# Autodesk Inventor assembly: pat de mijloc 125x190
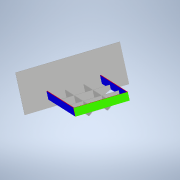
[picture p0: Inventor's stored thumbnail of the model, 180x180]
Saved by Autodesk Inventor 2022.6 (Build 266554000, 554)
## iProperties
Created: 2025-04-03
Part Number: pat de mijloc 125x190
Document SubType Name: Assembly
Designer: Dragos Macovei
Author: Dragos Macovei
## Documents named in this file (9)
- C:\Users\Dragos Macovei\Documents\Inventor_3d_parts\PAT\pat de mijloc 125x190.iam
- C:\Users\Dragos Macovei\Documents\Inventor_3d_parts\PAT\frontar.ipt
- C:\Users\Dragos Macovei\Documents\Inventor_3d_parts\PAT\laterala_dreapta.ipt
- C:\Users\Dragos Macovei\Documents\Inventor_3d_parts\PAT\laterala_stanga.ipt
- C:\Users\Dragos Macovei\Documents\Inventor_3d_parts\PAT\INTARITURA_STG_DR_MID.ipt
- C:\Users\Dragos Macovei\Documents\Inventor_3d_parts\PAT\INTARITURA_FRONTAR.ipt
- C:\Users\Dragos Macovei\Documents\Inventor_3d_parts\PAT\intaritura_centru.ipt
- C:\Users\Dragos Macovei\Documents\Inventor_3d_parts\PAT\intaritura_spatare.ipt
- C:\Users\Dragos Macovei\Documents\Inventor_3d_parts\PAT\spatar.ipt
## Components (12 placed, 8 different names)
1. frontar:1 — Mate:1, Flush:1, Flush:2, Flush:3, Flush:4, Mate:2, Mate:5, Mate:6
2. laterala_dreapta:1 — Mate:1, Flush:1, Flush:2, Mate:20
3. laterala_stanga:1 — Flush:3, Flush:4, Mate:2, Mate:3, Flush:5, Flush:6, Mate:4, Mate:19, Flush:14
4. INTARITURA_STG_DR_MID:1 — Mate:3, Flush:5, Mate:5, Mate:7, Mate:8, Flush:7, Flush:8, Mate:9, Mate:10
5. INTARITURA_STG_DR_MID:2 — Flush:6, Mate:4, Mate:6, Mate:11, Mate:12, Flush:9, Flush:10, Mate:13, Mate:14, Mate:15, Mate:16, Flush:11, Flush:12, Mate:17, Mate:18
6. INTARITURA_FRONTAR:1 — Mate:8, Flush:7, Mate:9
7. INTARITURA_FRONTAR:2 — Mate:7, Flush:8, Mate:10
8. intaritura_centru:1 — Mate:11, Flush:9, Mate:14
9. intaritura_centru:2 — Mate:12, Flush:10, Mate:13
10. intaritura_spatare:1 — Mate:16, Flush:11, Mate:17, Flush:13
11. intaritura_spatare:2 — Mate:15, Flush:12, Mate:18
12. spatar:1 — Mate:19, Mate:20, Flush:13, Flush:14
## Relationships (34: Mate 20, Flush 14)
- Mate:1: frontar:1 ↔ laterala_dreapta:1
- Flush:1: frontar:1 ↔ laterala_dreapta:1
- Flush:2: frontar:1 ↔ laterala_dreapta:1
- Flush:3: frontar:1 ↔ laterala_stanga:1
- Flush:4: frontar:1 ↔ laterala_stanga:1
- Mate:2: frontar:1 ↔ laterala_stanga:1
- Mate:3: laterala_stanga:1 ↔ INTARITURA_STG_DR_MID:1
- Flush:5 (-100 mm): laterala_stanga:1 ↔ INTARITURA_STG_DR_MID:1
- Flush:6 (100 mm): laterala_stanga:1 ↔ INTARITURA_STG_DR_MID:2
- Mate:4: laterala_stanga:1 ↔ INTARITURA_STG_DR_MID:2
- Mate:5 (630 mm): frontar:1 ↔ INTARITURA_STG_DR_MID:1
- Mate:6 (1260 mm): frontar:1 ↔ INTARITURA_STG_DR_MID:2
- Mate:7: INTARITURA_STG_DR_MID:1 ↔ INTARITURA_FRONTAR:2
- Mate:8: INTARITURA_STG_DR_MID:1 ↔ INTARITURA_FRONTAR:1
- Flush:7: INTARITURA_STG_DR_MID:1 ↔ INTARITURA_FRONTAR:1
- Flush:8: INTARITURA_STG_DR_MID:1 ↔ INTARITURA_FRONTAR:2
- Mate:9: INTARITURA_STG_DR_MID:1 ↔ INTARITURA_FRONTAR:1
- Mate:10: INTARITURA_STG_DR_MID:1 ↔ INTARITURA_FRONTAR:2
- Mate:11: INTARITURA_STG_DR_MID:2 ↔ intaritura_centru:1
- Mate:12: INTARITURA_STG_DR_MID:2 ↔ intaritura_centru:2
- Flush:9: INTARITURA_STG_DR_MID:2 ↔ intaritura_centru:1
- Flush:10: INTARITURA_STG_DR_MID:2 ↔ intaritura_centru:2
- Mate:13: INTARITURA_STG_DR_MID:2 ↔ intaritura_centru:2
- Mate:14: INTARITURA_STG_DR_MID:2 ↔ intaritura_centru:1
- Mate:15: INTARITURA_STG_DR_MID:2 ↔ intaritura_spatare:2
- Mate:16: INTARITURA_STG_DR_MID:2 ↔ intaritura_spatare:1
- Flush:11: INTARITURA_STG_DR_MID:2 ↔ intaritura_spatare:1
- Flush:12: INTARITURA_STG_DR_MID:2 ↔ intaritura_spatare:2
- Mate:17: INTARITURA_STG_DR_MID:2 ↔ intaritura_spatare:1
- Mate:18: INTARITURA_STG_DR_MID:2 ↔ intaritura_spatare:2
- Mate:19: laterala_stanga:1 ↔ spatar:1
- Mate:20: laterala_dreapta:1 ↔ spatar:1
- Flush:13: intaritura_spatare:1 ↔ spatar:1
- Flush:14 (600 mm): laterala_stanga:1 ↔ spatar:1
